# Autodesk Inventor assembly: Motor_Asembely_modul_1
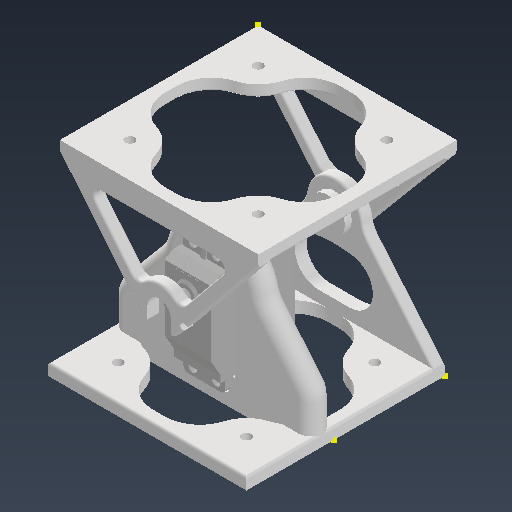
[picture p0: Inventor's stored thumbnail of the model, 512x512]
Saved by Autodesk Inventor 2027.1 (Build 311270010, 270A)
## iProperties
Created: 2026-09-25
Part Number: Motor_Asembely_modul_1
Document SubType Name: Assembly
Designer: evenb
Author: evenb
## Documents named in this file (6)
- C:\Users\evenb\OneDrive - NTNU\Documents\Skule\Master\MMA4004 Mekatronik og system integrering\Slange robot\Motor_Asembely_modul_1.iam
- C:\Users\evenb\OneDrive - NTNU\Documents\Skule\Master\MMA4004 Mekatronik og system integrering\Slange robot\Servo_motor_forenkla_1.ipt
- C:\Users\evenb\OneDrive - NTNU\Documents\Skule\Master\MMA4004 Mekatronik og system integrering\Slange robot\Modul_1_slange_robot_motor_slott.ipt
- C:\Users\evenb\OneDrive - NTNU\Documents\Skule\Master\MMA4004 Mekatronik og system integrering\Slange robot\Modul_2_slange_robot_motor_klammer.ipt
- C:\Users\evenb\OneDrive - NTNU\Documents\Skule\Master\MMA4004 Mekatronik og system integrering\Slange robot\forenklalager_14_5_5.ipt
- C:\Users\evenb\OneDrive - NTNU\Documents\Skule\Master\MMA4004 Mekatronik og system integrering\Slange robot\lagerpinn_mellom_moduler.ipt
## Components (5 placed, 5 different names)
1. Servo_motor_forenkla_1:1 — Angle:1, Angle:2, Mate:1, Mate:2, Mate:3
2. Modul_1_slange_robot_motor_slott:1 — Insert:2, Angle:3
3. Modul_2_slange_robot_motor_klammer:1 — Angle:1, Angle:2, Mate:1, Mate:2, Mate:3, Insert:1, Angle:3
4. forenklalager_14_5_5:1 — Insert:1, Insert:2, Insert:3
5. lagerpinn_mellom_moduler:1 — Insert:3
## Relationships (9: Angle 3, Mate 3, Insert 3)
- Angle:1 (0 deg): Servo_motor_forenkla_1:1 ↔ Modul_2_slange_robot_motor_klammer:1
- Angle:2 (180 deg): Servo_motor_forenkla_1:1 ↔ Modul_2_slange_robot_motor_klammer:1
- Mate:1: Servo_motor_forenkla_1:1 ↔ Modul_2_slange_robot_motor_klammer:1
- Mate:2: Servo_motor_forenkla_1:1 ↔ Modul_2_slange_robot_motor_klammer:1
- Mate:3: Servo_motor_forenkla_1:1 ↔ Modul_2_slange_robot_motor_klammer:1
- Insert:1: Modul_2_slange_robot_motor_klammer:1 ↔ forenklalager_14_5_5:1
- Insert:2: Modul_1_slange_robot_motor_slott:1 ↔ forenklalager_14_5_5:1
- Insert:3: forenklalager_14_5_5:1 ↔ lagerpinn_mellom_moduler:1
- Angle:3 (0 deg): Modul_1_slange_robot_motor_slott:1 ↔ Modul_2_slange_robot_motor_klammer:1
